# Autodesk Inventor assembly: Assembly1
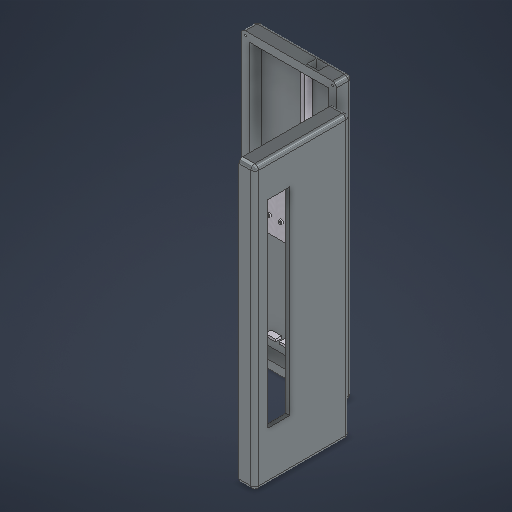
[picture p0: Inventor's stored thumbnail of the model, 512x512]
Saved by Autodesk Inventor 2027 (Build 310192060, 192F)
## iProperties
Created: 2026-10-01
Part Number: Assembly1
Document SubType Name: Assembly
Designer: Pablo
Author: Pablo
## Documents named in this file (3)
- F:\_Carpeta V Pablo\Documentos\Carrera\TFGs (6ºCarrera)\UBIBUS\Assembly1.iam
- F:\_Carpeta V Pablo\Documentos\Carrera\TFGs (6ºCarrera)\UBIBUS\Parte trasera.ipt
- F:\_Carpeta V Pablo\Documentos\Carrera\TFGs (6ºCarrera)\UBIBUS\Parte delantera.ipt
## Components (2 placed, 2 different names)
1. Parte trasera:1 — Flush:1
2. Parte delantera:2 — Flush:1
## Relationships (1: Flush 1)
- Flush:1: Parte trasera:1 ↔ Parte delantera:2
## Named parameters: Finish1_Area = 9145.6, Finish2_Area = 485.766
note: some values were not read from the file. Shown as the stored number, unit unknown: "Finish1_Area", "Finish2_Area".
